# Autodesk Inventor assembly: DTraining2_001_E2Assembly
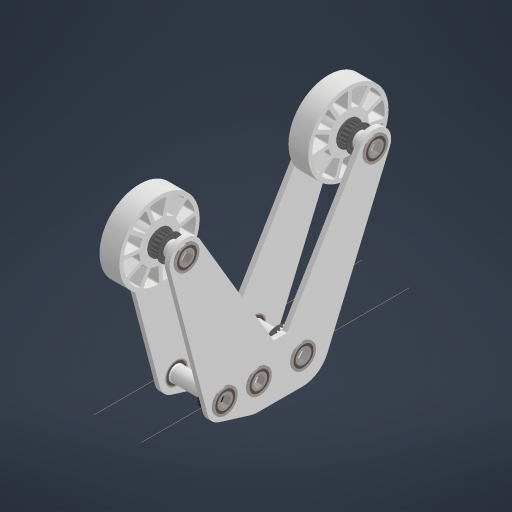
[picture p0: Inventor's stored thumbnail of the model, 512x512]
Saved by Autodesk Inventor 2024.4 (Build 284460000, 460)
## iProperties
Created: 2026-06-14
Part Number: DTraining2_001_E2Assembly
Document SubType Name: Assembly
Designer: hs4ho
Author: hs4ho
## Documents named in this file (10)
- C:\Users\hs4ho\OneDrive\Documents\GitHub\2026-2027-DesignTraining\DeanS\Design Training\Design Training 2\Exercise 2\DTraining2_001_E2Assembly.iam
- C:\Users\hs4ho\OneDrive\Documents\GitHub\2026-2027-DesignTraining\DeanS\Design Training\Design Training 2\Exercise 2\DTraining2_001_E2Base.ipt
- C:\Users\hs4ho\OneDrive\Documents\GitHub\2026-2027-DesignTraining\COTS Library\Motion\Bearings\COTS_WCP-0783_1.125ODHexBearing.ipt
- C:\Users\hs4ho\OneDrive\Documents\GitHub\2026-2027-DesignTraining\COTS Library\Motion\Gears\20DP gears\Aluminum\COTS_WCP-0703_24T_0.5inHex.ipt
- C:\Users\hs4ho\Downloads\WCP-0713\WCP-0713\WCP-0713.ipt
- C:\Users\hs4ho\OneDrive\Documents\GitHub\2026-2027-DesignTraining\COTS Library\Motion\Pulleys\HTD5M\10mm Wide\COTS_WCP-0563_18t_HTD5M.ipt
- C:\Users\hs4ho\Downloads\am-3480 4IN 500Hex Bore Compliant Wheel REV2\am-3480 4IN 500Hex Bore Compliant Wheel REV2\am-3480 4IN 500Hex Bore Compliant Wheel REV2.ipt
- C:\Users\hs4ho\Downloads\WCP-0787\WCP-0787\WCP-0787.ipt
- C:\Users\hs4ho\OneDrive\Documents\GitHub\2026-2027-DesignTraining\DeanS\Design Training\Design Training 2\Exercise 2\DTraining2_001_E2Spacer,5in.ipt
- C:\Users\hs4ho\OneDrive\Documents\GitHub\2026-2027-DesignTraining\DeanS\Design Training\Design Training 2\Exercise 2\DTraining2_001_E2Spacer1,561in.ipt
## Components (33 placed, 9 different names)
1. DTraining2_001_E2Base:1 — Mate:1, Mate:2, Mate:3, Mate:4, Mate:5, Mate:16, Mate:17, Mate:18, Mate:19, Mate:20, Mate:21, Mate:22, Mate:23, Mate:24, Mate:25
2. DTraining2_001_E2Base:2 — Mate:1, Mate:2, Mate:3, Mate:4, Mate:5, Mate:6, Mate:7, Mate:8, Mate:9, Mate:10, Mate:11, Mate:12, Mate:13, Mate:14, Mate:15
3. COTS_WCP-0783_1.125ODHexBearing:1 — Mate:6, Mate:7, Mate:45, Mate:46, Angle:11, Angle:27
4. COTS_WCP-0783_1.125ODHexBearing:2 — Mate:8, Mate:12, Mate:29, Angle:3, Mate:31, Angle:26
5. COTS_WCP-0783_1.125ODHexBearing:3 — Mate:9, Mate:13, Mate:28, Angle:2, Mate:30, Angle:25
6. COTS_WCP-0783_1.125ODHexBearing:4 — Mate:10, Mate:14, Mate:26, Angle:1, Mate:27, Angle:24
7. COTS_WCP-0783_1.125ODHexBearing:5 — Mate:11, Mate:15, Mate:44, Mate:47, Angle:10, Angle:28
8. COTS_WCP-0783_1.125ODHexBearing:6 — Mate:16, Mate:21, Mate:38, Mate:39, Angle:7, Mate:41, Angle:27
9. COTS_WCP-0783_1.125ODHexBearing:7 — Mate:17, Mate:25, Mate:56, Angle:16, Mate:57, Angle:26
10. COTS_WCP-0783_1.125ODHexBearing:8 — Mate:18, Mate:24, Mate:54, Angle:15, Mate:55, Angle:25
11. COTS_WCP-0783_1.125ODHexBearing:9 — Mate:19, Mate:23, Mate:52, Angle:14, Mate:53, Angle:24
12. COTS_WCP-0783_1.125ODHexBearing:10 — Mate:20, Mate:22, Mate:36, Mate:37, Angle:6, Mate:40, Angle:28
13. COTS_WCP-0703_24T_0.5inHex:1 — Mate:26, Angle:1, Mate:27
14. WCP-0713:1 — Mate:28, Angle:2, Mate:30, Mate:32, Angle:4, Mate:35
15. WCP-0713:2 — Mate:29, Angle:3, Mate:31, Mate:33, Angle:5, Mate:34
16. COTS_WCP-0563_18t_HTD5M:1 — Mate:32, Angle:4, Mate:35
17. COTS_WCP-0563_18t_HTD5M:2 — Mate:33, Angle:5, Mate:34
18. am-3480 4IN 500Hex Bore Compliant Wheel REV2:1 — Mate:41, Mate:43, Angle:9
19. am-3480 4IN 500Hex Bore Compliant Wheel REV2:2 — Mate:40, Mate:42, Angle:8
20. WCP-0787:1 — Mate:36, Mate:37, Angle:6, Mate:42, Angle:8
21. WCP-0787:2 — Mate:38, Mate:39, Angle:7, Mate:43, Angle:9
22. COTS_WCP-0563_18t_HTD5M:3 — Mate:49, Mate:51, Angle:12
23. COTS_WCP-0563_18t_HTD5M:4 — Mate:48, Mate:50, Angle:13
24. DTraining2_001_E2Spacer,5in:1 — Mate:45, Mate:46, Angle:11, Mate:49, Mate:51, Angle:12
25. DTraining2_001_E2Spacer,5in:2 — Mate:44, Mate:47, Angle:10, Mate:48, Mate:50, Angle:13
26. WCP-0787:3 — Mate:54, Angle:15, Mate:55, Mate:64, Mate:65, Angle:20
27. WCP-0787:4 — Mate:52, Angle:14, Mate:53, Mate:70, Mate:71, Angle:29
28. WCP-0787:5 — Mate:56, Angle:16, Mate:57, Mate:68, Mate:69, Angle:22
29. DTraining2_001_E2Spacer,5in:3 — Mate:58, Mate:59, Angle:17, Mate:64, Mate:65, Angle:20
30. DTraining2_001_E2Spacer,5in:4 — Mate:58, Mate:59, Angle:17
31. DTraining2_001_E2Spacer,5in:7 — Mate:66, Mate:67, Angle:21, Mate:69, Angle:22
32. DTraining2_001_E2Spacer,5in:8 — Mate:66, Mate:67, Angle:21, Mate:68
33. DTraining2_001_E2Spacer1,561in:1 — Mate:70, Mate:71, Angle:29
## Relationships (93: Mate 67, Angle 26)
- Mate:1: DTraining2_001_E2Base:1 ↔ DTraining2_001_E2Base:2
- Mate:2: DTraining2_001_E2Base:1 ↔ DTraining2_001_E2Base:2
- Mate:3: DTraining2_001_E2Base:1 ↔ DTraining2_001_E2Base:2
- Mate:4: DTraining2_001_E2Base:1 ↔ DTraining2_001_E2Base:2
- Mate:5: DTraining2_001_E2Base:1 ↔ DTraining2_001_E2Base:2
- Mate:6: DTraining2_001_E2Base:2 ↔ COTS_WCP-0783_1.125ODHexBearing:1
- Mate:7: DTraining2_001_E2Base:2 ↔ COTS_WCP-0783_1.125ODHexBearing:1
- Mate:8: DTraining2_001_E2Base:2 ↔ COTS_WCP-0783_1.125ODHexBearing:2
- Mate:9: DTraining2_001_E2Base:2 ↔ COTS_WCP-0783_1.125ODHexBearing:3
- Mate:10: DTraining2_001_E2Base:2 ↔ COTS_WCP-0783_1.125ODHexBearing:4
- Mate:11: DTraining2_001_E2Base:2 ↔ COTS_WCP-0783_1.125ODHexBearing:5
- Mate:12: DTraining2_001_E2Base:2 ↔ COTS_WCP-0783_1.125ODHexBearing:2
- Mate:13: DTraining2_001_E2Base:2 ↔ COTS_WCP-0783_1.125ODHexBearing:3
- Mate:14: DTraining2_001_E2Base:2 ↔ COTS_WCP-0783_1.125ODHexBearing:4
- Mate:15: DTraining2_001_E2Base:2 ↔ COTS_WCP-0783_1.125ODHexBearing:5
- Mate:16: DTraining2_001_E2Base:1 ↔ COTS_WCP-0783_1.125ODHexBearing:6
- Mate:17: DTraining2_001_E2Base:1 ↔ COTS_WCP-0783_1.125ODHexBearing:7
- Mate:18: DTraining2_001_E2Base:1 ↔ COTS_WCP-0783_1.125ODHexBearing:8
- Mate:19: DTraining2_001_E2Base:1 ↔ COTS_WCP-0783_1.125ODHexBearing:9
- Mate:20: DTraining2_001_E2Base:1 ↔ COTS_WCP-0783_1.125ODHexBearing:10
- Mate:21: DTraining2_001_E2Base:1 ↔ COTS_WCP-0783_1.125ODHexBearing:6
- Mate:22: DTraining2_001_E2Base:1 ↔ COTS_WCP-0783_1.125ODHexBearing:10
- Mate:23: DTraining2_001_E2Base:1 ↔ COTS_WCP-0783_1.125ODHexBearing:9
- Mate:24: DTraining2_001_E2Base:1 ↔ COTS_WCP-0783_1.125ODHexBearing:8
- Mate:25: DTraining2_001_E2Base:1 ↔ COTS_WCP-0783_1.125ODHexBearing:7
- Mate:26: COTS_WCP-0783_1.125ODHexBearing:4 ↔ COTS_WCP-0703_24T_0.5inHex:1
- Angle:1 (0 deg): COTS_WCP-0783_1.125ODHexBearing:4 ↔ COTS_WCP-0703_24T_0.5inHex:1
- Mate:27: COTS_WCP-0783_1.125ODHexBearing:4 ↔ COTS_WCP-0703_24T_0.5inHex:1
- Mate:28: COTS_WCP-0783_1.125ODHexBearing:3 ↔ WCP-0713:1
- Mate:29: COTS_WCP-0783_1.125ODHexBearing:2 ↔ WCP-0713:2
- Angle:2 (0 deg): COTS_WCP-0783_1.125ODHexBearing:3 ↔ WCP-0713:1
- Angle:3 (0 deg): COTS_WCP-0783_1.125ODHexBearing:2 ↔ WCP-0713:2
- Mate:30: COTS_WCP-0783_1.125ODHexBearing:3 ↔ WCP-0713:1
- Mate:31: COTS_WCP-0783_1.125ODHexBearing:2 ↔ WCP-0713:2
- Mate:32: WCP-0713:1 ↔ COTS_WCP-0563_18t_HTD5M:1
- Mate:33: WCP-0713:2 ↔ COTS_WCP-0563_18t_HTD5M:2
- Angle:4 (0 deg): WCP-0713:1 ↔ COTS_WCP-0563_18t_HTD5M:1
- Angle:5 (0 deg): WCP-0713:2 ↔ COTS_WCP-0563_18t_HTD5M:2
- Mate:34: WCP-0713:2 ↔ COTS_WCP-0563_18t_HTD5M:2
- Mate:35: WCP-0713:1 ↔ COTS_WCP-0563_18t_HTD5M:1
- Mate:36: COTS_WCP-0783_1.125ODHexBearing:10 ↔ WCP-0787:1
- Mate:37: COTS_WCP-0783_1.125ODHexBearing:10 ↔ WCP-0787:1
- Angle:6 (0 deg): COTS_WCP-0783_1.125ODHexBearing:10 ↔ WCP-0787:1
- Mate:38: COTS_WCP-0783_1.125ODHexBearing:6 ↔ WCP-0787:2
- Mate:39: COTS_WCP-0783_1.125ODHexBearing:6 ↔ WCP-0787:2
- Angle:7 (0 deg): COTS_WCP-0783_1.125ODHexBearing:6 ↔ WCP-0787:2
- Mate:40: COTS_WCP-0783_1.125ODHexBearing:10 ↔ am-3480 4IN 500Hex Bore Compliant Wheel REV2:2
- Mate:41: COTS_WCP-0783_1.125ODHexBearing:6 ↔ am-3480 4IN 500Hex Bore Compliant Wheel REV2:1
- Mate:42: am-3480 4IN 500Hex Bore Compliant Wheel REV2:2 ↔ WCP-0787:1
- Angle:8 (0 deg): am-3480 4IN 500Hex Bore Compliant Wheel REV2:2 ↔ WCP-0787:1
- Mate:43: am-3480 4IN 500Hex Bore Compliant Wheel REV2:1 ↔ WCP-0787:2
- Angle:9 (0 deg): am-3480 4IN 500Hex Bore Compliant Wheel REV2:1 ↔ WCP-0787:2
- Mate:44: COTS_WCP-0783_1.125ODHexBearing:5 ↔ DTraining2_001_E2Spacer,5in:2
- Mate:45: COTS_WCP-0783_1.125ODHexBearing:1 ↔ DTraining2_001_E2Spacer,5in:1
- Mate:46: COTS_WCP-0783_1.125ODHexBearing:1 ↔ DTraining2_001_E2Spacer,5in:1
- Mate:47: COTS_WCP-0783_1.125ODHexBearing:5 ↔ DTraining2_001_E2Spacer,5in:2
- Angle:10 (0 deg): COTS_WCP-0783_1.125ODHexBearing:5 ↔ DTraining2_001_E2Spacer,5in:2
- Angle:11 (0 deg): COTS_WCP-0783_1.125ODHexBearing:1 ↔ DTraining2_001_E2Spacer,5in:1
- Mate:48: COTS_WCP-0563_18t_HTD5M:4 ↔ DTraining2_001_E2Spacer,5in:2
- Mate:49: COTS_WCP-0563_18t_HTD5M:3 ↔ DTraining2_001_E2Spacer,5in:1
- Mate:50: COTS_WCP-0563_18t_HTD5M:4 ↔ DTraining2_001_E2Spacer,5in:2
- Mate:51: COTS_WCP-0563_18t_HTD5M:3 ↔ DTraining2_001_E2Spacer,5in:1
- Angle:12 (0 deg): COTS_WCP-0563_18t_HTD5M:3 ↔ DTraining2_001_E2Spacer,5in:1
- Angle:13 (0 deg): COTS_WCP-0563_18t_HTD5M:4 ↔ DTraining2_001_E2Spacer,5in:2
- Mate:52: COTS_WCP-0783_1.125ODHexBearing:9 ↔ WCP-0787:4
- Angle:14 (0 deg): COTS_WCP-0783_1.125ODHexBearing:9 ↔ WCP-0787:4
- Mate:53: COTS_WCP-0783_1.125ODHexBearing:9 ↔ WCP-0787:4
- Mate:54: COTS_WCP-0783_1.125ODHexBearing:8 ↔ WCP-0787:3
- Angle:15 (0 deg): COTS_WCP-0783_1.125ODHexBearing:8 ↔ WCP-0787:3
- Mate:55: COTS_WCP-0783_1.125ODHexBearing:8 ↔ WCP-0787:3
- Mate:56: COTS_WCP-0783_1.125ODHexBearing:7 ↔ WCP-0787:5
- Angle:16 (0 deg): COTS_WCP-0783_1.125ODHexBearing:7 ↔ WCP-0787:5
- Mate:57: COTS_WCP-0783_1.125ODHexBearing:7 ↔ WCP-0787:5
- Mate:58: DTraining2_001_E2Spacer,5in:3 ↔ DTraining2_001_E2Spacer,5in:4
- Mate:59: DTraining2_001_E2Spacer,5in:3 ↔ DTraining2_001_E2Spacer,5in:4
- Angle:17 (0 deg): DTraining2_001_E2Spacer,5in:3 ↔ DTraining2_001_E2Spacer,5in:4
- Mate:64: WCP-0787:3 ↔ DTraining2_001_E2Spacer,5in:3
- Mate:65: WCP-0787:3 ↔ DTraining2_001_E2Spacer,5in:3
- Angle:20 (0 deg): WCP-0787:3 ↔ DTraining2_001_E2Spacer,5in:3
- Mate:66: DTraining2_001_E2Spacer,5in:7 ↔ DTraining2_001_E2Spacer,5in:8
- Mate:67: DTraining2_001_E2Spacer,5in:7 ↔ DTraining2_001_E2Spacer,5in:8
- Angle:21 (0 deg): DTraining2_001_E2Spacer,5in:7 ↔ DTraining2_001_E2Spacer,5in:8
- Mate:68: WCP-0787:5 ↔ DTraining2_001_E2Spacer,5in:8
- Mate:69: WCP-0787:5 ↔ DTraining2_001_E2Spacer,5in:7
- Angle:22 (0 deg): WCP-0787:5 ↔ DTraining2_001_E2Spacer,5in:7
- Angle:24 (0 deg): COTS_WCP-0783_1.125ODHexBearing:4 ↔ COTS_WCP-0783_1.125ODHexBearing:9
- Angle:25 (0 deg): COTS_WCP-0783_1.125ODHexBearing:3 ↔ COTS_WCP-0783_1.125ODHexBearing:8
- Angle:26 (0 deg): COTS_WCP-0783_1.125ODHexBearing:2 ↔ COTS_WCP-0783_1.125ODHexBearing:7
- Angle:27 (0 deg): COTS_WCP-0783_1.125ODHexBearing:1 ↔ COTS_WCP-0783_1.125ODHexBearing:6
- Angle:28 (0 deg): COTS_WCP-0783_1.125ODHexBearing:5 ↔ COTS_WCP-0783_1.125ODHexBearing:10
- Mate:70: WCP-0787:4 ↔ DTraining2_001_E2Spacer1,561in:1
- Mate:71: WCP-0787:4 ↔ DTraining2_001_E2Spacer1,561in:1
- Angle:29 (0 deg): WCP-0787:4 ↔ DTraining2_001_E2Spacer1,561in:1
